# Autodesk Inventor assembly: PROTOTIPO FINAL
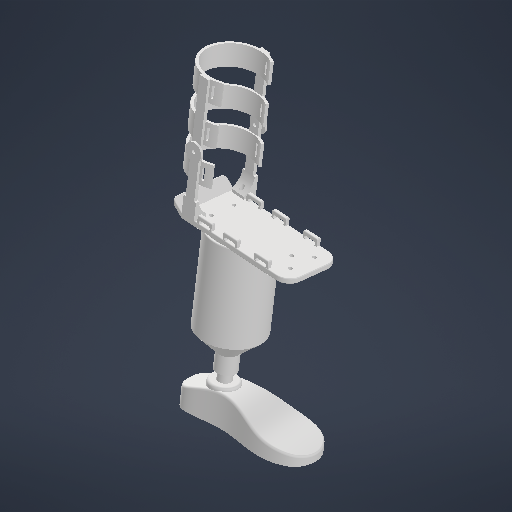
[picture p0: Inventor's stored thumbnail of the model, 512x512]
Saved by Autodesk Inventor 2026 (Build 300175000, 175)
## iProperties
Created: 2026-10-26
Part Number: PROTOTIPO FINAL
Document SubType Name: Assembly
Designer: aml
Author: aml
## Documents named in this file (5)
- C:\Users\aml\Desktop\PROTOTIPO FINAL.iam
- C:\Users\aml\Desktop\modulo_medio_cazoleta_pilon\modulo_medio_cazoleta_pilon\modulo_medio_cazoleta_pilon.ipt
- C:\Users\aml\Desktop\plataforma_pie_talla44\plataforma_pie_talla44\plataforma_pie_talla44.ipt
- C:\Users\aml\Desktop\pilon_superior_30cm\pilon_superior_30cm\pilon_superior_30cm.ipt
- C:\Users\aml\Desktop\ortesis_adaptada_plataforma\ortesis_adaptada_plataforma\ortesis_adaptada_plataforma.ipt
## Components (4 placed, 4 different names)
1. modulo_medio_cazoleta_pilon:1 — Rotational:1
2. plataforma_pie_talla44:1 — Rigid:1, Mate:1, Rigid:2, Mate:2
3. pilon_superior_30cm:1 — Rotational:1, Rigid:1, Mate:1, Rigid:2
4. ortesis_adaptada_plataforma:1 — Mate:2
## Relationships (5: WeldJoint 2, Mate 2, RevoluteJoint 1)
- Rotational:1 [RevoluteJoint]: modulo_medio_cazoleta_pilon:1 ↔ pilon_superior_30cm:1
- Rigid:1 [WeldJoint]: plataforma_pie_talla44:1 ↔ pilon_superior_30cm:1
- Mate:1: plataforma_pie_talla44:1 ↔ pilon_superior_30cm:1
- Rigid:2 [WeldJoint] (3.175 mm): plataforma_pie_talla44:1 ↔ pilon_superior_30cm:1
- Mate:2: plataforma_pie_talla44:1 ↔ ortesis_adaptada_plataforma:1
